# Autodesk Inventor assembly: Motor Mount Assy
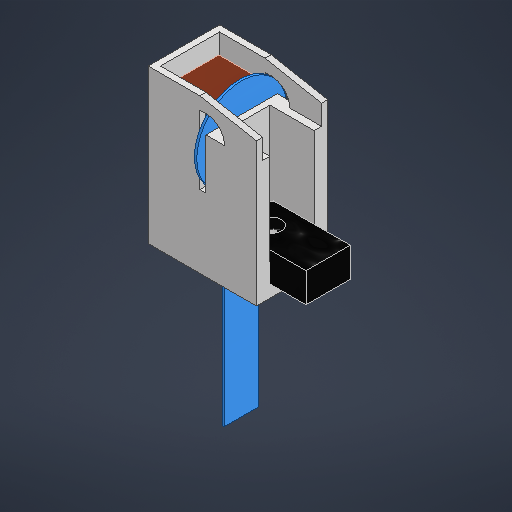
[picture p0: Inventor's stored thumbnail of the model, 512x512]
Saved by Autodesk Inventor 2026.2 (Build 302298000, 298)
## iProperties
Created: 2026-11-10
Part Number: Motor Mount Assy
Document SubType Name: Assembly
Designer: Carro
Author: Carro
## Documents named in this file (5)
- C:\Users\Carro\OneDrive\Documents\GitHub\Mechatronics-Carwash\3D Models\Brushes\Motor Mount Assy.iam
- C:\Users\Carro\OneDrive\Documents\GitHub\Mechatronics-Carwash\3D Models\Brushes\Motor Mount.ipt
- C:\Users\Carro\OneDrive\Documents\GitHub\Mechatronics-Carwash\3D Models\Brushes\Motor.ipt
- C:\Users\Carro\OneDrive\Documents\GitHub\Mechatronics-Carwash\3D Models\Brushes\Pressure Sensor.ipt
- C:\Users\Carro\OneDrive\Documents\GitHub\Mechatronics-Carwash\3D Models\Brushes\Linear Actuator Tip.ipt
## Components (4 placed, 4 different names)
1. Motor Mount:1 — Mate:1, Mate:2, Mate:3, Mate:4, Angle:1, Mate:5, Mate:6, Mate:7
2. Motor:1 — Mate:1, Mate:5, Mate:6
3. Pressure Sensor:1 — Mate:2, Mate:7
4. Linear Actuator Tip:1 — Mate:3, Mate:4, Angle:1
## Relationships (8: Mate 7, Angle 1)
- Mate:1: Motor Mount:1 ↔ Motor:1
- Mate:2: Motor Mount:1 ↔ Pressure Sensor:1
- Mate:3: Motor Mount:1 ↔ Linear Actuator Tip:1
- Mate:4: Motor Mount:1 ↔ Linear Actuator Tip:1
- Angle:1 (0 deg): Motor Mount:1 ↔ Linear Actuator Tip:1
- Mate:5: Motor Mount:1 ↔ Motor:1
- Mate:6: Motor Mount:1 ↔ Motor:1
- Mate:7: Motor Mount:1 ↔ Pressure Sensor:1
